# Autodesk Inventor assembly: SE0001AN000_G01_201
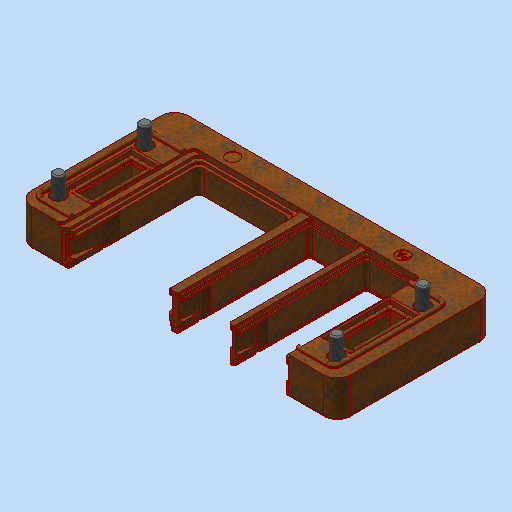
[picture p0: Inventor's stored thumbnail of the model, 512x512]
Saved by Autodesk Inventor 2023.3 (Build 273359000, 359)
## iProperties
Created: 2015-11-17
Part Number: SE0001AN000_G01_201
Document SubType Name: Assembly
Designer: pts9bw
Description: =<RBPARTNOTITLE2>
Vendor: --
Mass: 10.4115 g
Surface Area: 15.3449 cm^2
Volume: 1.32631 cm^3
Density: 7.85 g/cm^3
AnP_Kommentar_aktuell: =<Comments>
AnP_Material_aktuell: =<Material>
RBMATERIAL: =<Material>
RBMATNO: =<Part Number>
RBPARTNOTITLE1: Modlink MSDD
RBPARTNOTITLE2: Modlink MSDD Schaltschrankdurchführung  mit Schrauben
AnP_Kategorie: 98
AnP_Material: =<Material>
RBDRAWINGMISSINGSPEC: --
Author: pts9bw
Keywords: =<RBPARTMADEOF>
Comments: =<RBSURFACE2>
Revision Number: 01
## Documents named in this file (3)
- C:\Users\rea9an\Documents\Inventor\TCAI2412_te1910_EM\AS00000981.iam
- C:\Users\rea9an\Documents\Inventor\TCAI2412_te1910_EM\PT00004794.ipt
- C:\Users\rea9an\Documents\Inventor\TCAI2412_te1910_EM\PT00004869.ipt
## Components (5 placed, 2 different names)
1. PT00004794:1
2. PT00004869:1
3. PT00004869:2
4. PT00004869:3
5. PT00004869:4
## Relationships (4: Insert 4)
- [Insert]: PT00004794:1 ↔ PT00004869:1
- [Insert]: PT00004794:1 ↔ PT00004869:2
- [Insert]: PT00004794:1 ↔ PT00004869:3
- [Insert]: PT00004794:1 ↔ PT00004869:4
